# Autodesk Inventor assembly: DIFF ASSEM
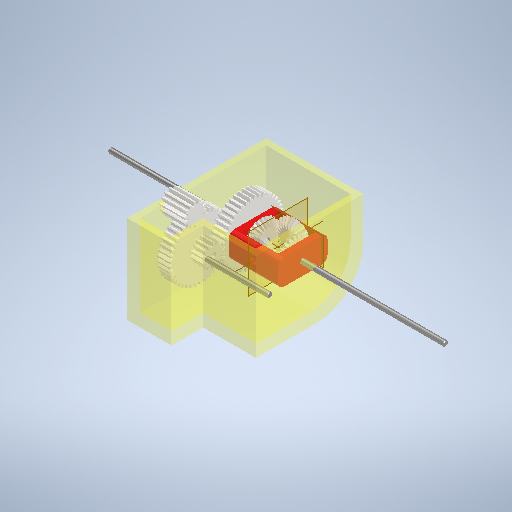
[picture p0: Inventor's stored thumbnail of the model, 512x512]
Saved by Autodesk Inventor 2026.3 (Build 303398000, 398)
## iProperties
Created: 2026-10-21
Part Number: DIFF ASSEM
Document SubType Name: Assembly
Designer: Salim
Author: Salim
## Documents named in this file (4)
- C:\Users\Salim\OneDrive - Universitas Negeri Malang\!! MIZURO\!!!!!!!!KSTI 2026\mizuro-ksti2026-muv\mechanical\3d design\DIFF ASSEM.iam
- C:\Users\Salim\OneDrive - Universitas Negeri Malang\!! MIZURO\!!!!!!!!KSTI 2026\mizuro-ksti2026-muv\mechanical\3d design\3DP DIFF.iam
- C:\Users\Salim\OneDrive - Universitas Negeri Malang\!! MIZURO\!!!!!!!!KSTI 2026\mizuro-ksti2026-muv\mechanical\3d design\DIFF CASE.ipt
- C:\Users\Salim\OneDrive - Universitas Negeri Malang\!! MIZURO\!!!!!!!!KSTI 2026\mizuro-ksti2026-muv\mechanical\3d design\77MM-4MM ROD.ipt
## Components (3 placed, 3 different names)
1. 3DP DIFF:1 [sub-assembly]
2. DIFF CASE:1 — Rigid:1
3. 77MM-4MM ROD:1 — Rigid:1
## Relationships (1: WeldJoint 1)
- Rigid:1 [WeldJoint]: DIFF CASE:1 ↔ 77MM-4MM ROD:1
